# Autodesk Inventor assembly: Cell_String
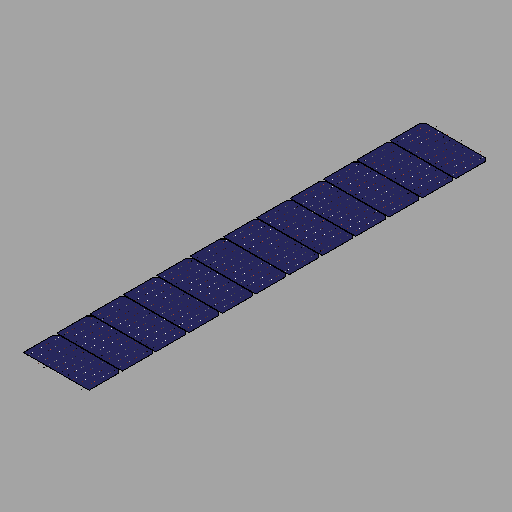
[picture p0: Inventor's stored thumbnail of the model, 512x512]
Saved by Autodesk Inventor 2026.2 (Build 302298000, 298)
## iProperties
Created: 2026-11-08
Part Number: Cell_String
Document SubType Name: Assembly
Designer: Jacob
Author: Jacob
## Documents named in this file (5)
- C:\projects\3D\Cell_String.iam
- C:\projects\3D\Half_Cut_Cell.ipt
- C:\projects\3D\Cell_Ribbon.ipt
- C:\projects\3D\Cell_Ribbon_Start.ipt
- C:\projects\3D\Cell_Ribbon_End.ipt
## Components (142 placed, 4 different names)
1. Half_Cut_Cell:2 — Flush:1, Flush:2, Flush:3
2. Half_Cut_Cell:3
3. Half_Cut_Cell:4
4. Half_Cut_Cell:5
5. Half_Cut_Cell:6
6. Half_Cut_Cell:7
7. Half_Cut_Cell:8
8. Half_Cut_Cell:9
9. Half_Cut_Cell:10
10. Half_Cut_Cell:11
11. Half_Cut_Cell:12
12. Half_Cut_Cell:13
13. Cell_Ribbon:2 — Flush:4, Flush:5, Flush:6
14. Cell_Ribbon:3
15. Cell_Ribbon:4
16. Cell_Ribbon:5
17. Cell_Ribbon:6
18. Cell_Ribbon:7
19. Cell_Ribbon:8
20. Cell_Ribbon:9
21. Cell_Ribbon:10
22. Cell_Ribbon:11
23. Cell_Ribbon:12
24. Cell_Ribbon:13
25. Cell_Ribbon:14
26. Cell_Ribbon:15
27. Cell_Ribbon:16
28. Cell_Ribbon:17
29. Cell_Ribbon:18
30. Cell_Ribbon:19
31. Cell_Ribbon:20
32. Cell_Ribbon:21
33. Cell_Ribbon:22
34. Cell_Ribbon:23
35. Cell_Ribbon:24
36. Cell_Ribbon:25
37. Cell_Ribbon:26
38. Cell_Ribbon:27
39. Cell_Ribbon:28
40. Cell_Ribbon:29
41. Cell_Ribbon:30
42. Cell_Ribbon:31
43. Cell_Ribbon:32
44. Cell_Ribbon:33
45. Cell_Ribbon:34
46. Cell_Ribbon:35
47. Cell_Ribbon:36
48. Cell_Ribbon:37
49. Cell_Ribbon:38
50. Cell_Ribbon:39
51. Cell_Ribbon:40
52. Cell_Ribbon:41
53. Cell_Ribbon:42
54. Cell_Ribbon:43
55. Cell_Ribbon:44
56. Cell_Ribbon:45
57. Cell_Ribbon:46
58. Cell_Ribbon:47
59. Cell_Ribbon:48
60. Cell_Ribbon:49
61. Cell_Ribbon:50
62. Cell_Ribbon:51
63. Cell_Ribbon:52
64. Cell_Ribbon:53
65. Cell_Ribbon:54
66. Cell_Ribbon:55
67. Cell_Ribbon:56
68. Cell_Ribbon:57
69. Cell_Ribbon:58
70. Cell_Ribbon:59
71. Cell_Ribbon:60
72. Cell_Ribbon:61
73. Cell_Ribbon:62
74. Cell_Ribbon:63
75. Cell_Ribbon:64
76. Cell_Ribbon:65
77. Cell_Ribbon:66
78. Cell_Ribbon:67
79. Cell_Ribbon:68
80. Cell_Ribbon:69
81. Cell_Ribbon:70
82. Cell_Ribbon:71
83. Cell_Ribbon:72
84. Cell_Ribbon:73
85. Cell_Ribbon:74
86. Cell_Ribbon:75
87. Cell_Ribbon:76
88. Cell_Ribbon:77
89. Cell_Ribbon:78
90. Cell_Ribbon:79
91. Cell_Ribbon:80
92. Cell_Ribbon:81
93. Cell_Ribbon:82
94. Cell_Ribbon:83
95. Cell_Ribbon:84
96. Cell_Ribbon:85
97. Cell_Ribbon:86
98. Cell_Ribbon:87
99. Cell_Ribbon:88
100. Cell_Ribbon:89
101. Cell_Ribbon:90
102. Cell_Ribbon:91
103. Cell_Ribbon:92
104. Cell_Ribbon:93
105. Cell_Ribbon:94
106. Cell_Ribbon:95
107. Cell_Ribbon:96
108. Cell_Ribbon:97
109. Cell_Ribbon:98
110. Cell_Ribbon:99
111. Cell_Ribbon:100
112. Cell_Ribbon:101
113. Cell_Ribbon:102
114. Cell_Ribbon:103
115. Cell_Ribbon:104
116. Cell_Ribbon:105
117. Cell_Ribbon:106
118. Cell_Ribbon:107
119. Cell_Ribbon:108
120. Cell_Ribbon:109
121. Cell_Ribbon:110
122. Cell_Ribbon:111
123. Cell_Ribbon_Start:1 — Flush:7, Flush:8, Flush:9
124. Cell_Ribbon_Start:2
125. Cell_Ribbon_Start:3
126. Cell_Ribbon_Start:4
127. Cell_Ribbon_Start:5
128. Cell_Ribbon_Start:6
129. Cell_Ribbon_Start:7
130. Cell_Ribbon_Start:8
131. Cell_Ribbon_Start:9
132. Cell_Ribbon_Start:10
133. Cell_Ribbon_End:1 — Flush:10, Flush:11, Flush:12
134. Cell_Ribbon_End:2
135. Cell_Ribbon_End:3
136. Cell_Ribbon_End:4
137. Cell_Ribbon_End:5
138. Cell_Ribbon_End:6
139. Cell_Ribbon_End:7
140. Cell_Ribbon_End:8
141. Cell_Ribbon_End:9
142. Cell_Ribbon_End:10
## Component patterns: Cell_Array (12 elements), Interconnect_Ribbon_Array (110 elements), Start_Ribbon_Array (10 elements), End_Ribbon_Array (10 elements)
## Relationships (12: Flush 12)
- Flush:1: Half_Cut_Cell:2
- Flush:2: Half_Cut_Cell:2
- Flush:3 (-508.75 mm): Half_Cut_Cell:2
- Flush:4 (-77.85 mm): Cell_Ribbon:2
- Flush:5: Cell_Ribbon:2
- Flush:6 (-462.5 mm): Cell_Ribbon:2
- Flush:7 (-77.85 mm): Cell_Ribbon_Start:1
- Flush:8: Cell_Ribbon_Start:1
- Flush:9 (-554.3 mm): Cell_Ribbon_Start:1
- Flush:10 (-77.85 mm): Cell_Ribbon_End:1
- Flush:11: Cell_Ribbon_End:1
- Flush:12 (554.3 mm): Cell_Ribbon_End:1
## Named parameters: Cell_Width = 182.2 mm, Cell_Length = 91.1 mm, Cell_Thickness = 0.165 mm, Cu_Dia = 0.27 mm, Coating_Thickness = 0.015 mm, Wire_OD = 0.3 mm, Cell_Gap = 1.4 mm, Ribbon_Pad_Length = 83.17 mm, Ribbon_Overhang = 8 mm, Cell_Count = 12, Ribbon_Count = 10, Edge_To_First_Ribbon = 13.25 mm, Ribbon_Pitch = 17.3 mm, Cell_Pitch = 92.5 mm, Gap_Count = 11, Cell_Start_Z = -508.75 mm, Gap_Start_Z = -462.5 mm, String_Start_Z = -554.3 mm, String_End_Z = 554.3 mm, Ribbon_Start_X = -77.85 mm
